# Autodesk Inventor assembly: Baugruppe1
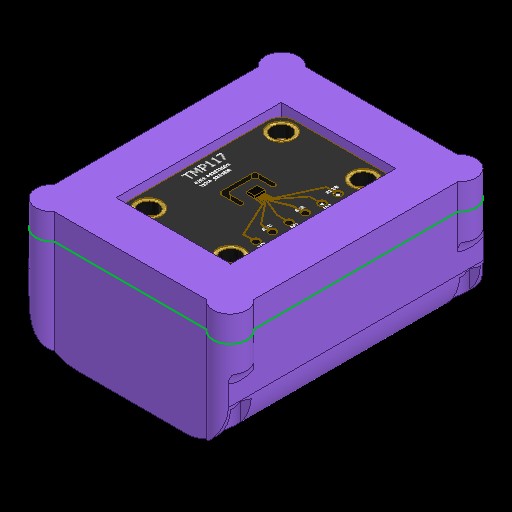
[picture p0: Inventor's stored thumbnail of the model, 512x512]
Saved by Autodesk Inventor 2027.1 (Build 311270010, 270A)
## iProperties
Created: 2026-10-09
Part Number: Baugruppe1
Document SubType Name: Assembly
Designer: josia
Author: josia
## Documents named in this file (10)
- C:\Users\josia\OneDrive\Desktop\Projekte\TemperaturSensor\tmp117_Temp_Sensor\Temp_Sensor.iam
- C:\Users\josia\OneDrive\Desktop\Projekte\TemperaturSensor\tmp117_Temp_Sensor\Verschiedene_ESP32_C3_Super_Mini_3DModele\ESP32 C3 Super mini (PINK)\ESP32 C3 Super mini (PINK).ipt
- C:\Users\josia\OneDrive\Desktop\Projekte\TemperaturSensor\tmp117_Temp_Sensor\Temp_Basis_Platte.ipt
- C:\Users\josia\OneDrive\Desktop\Projekte\TemperaturSensor\tmp117_Temp_Sensor\Pin_7mm.ipt
- C:\Users\josia\OneDrive\Desktop\Projekte\TemperaturSensor\tmp117_Temp_Sensor\charging-module-tp4057-mini-1\Charging Module TP4057 Mini\Charging Module TP4057 Mini.iam
- C:\Users\josia\OneDrive\Desktop\Projekte\TemperaturSensor\tmp117_Temp_Sensor\Li-Ion_akku_502030.ipt
- C:\Users\josia\OneDrive\Desktop\Projekte\TemperaturSensor\tmp117_Temp_Sensor\Wasserdichter_USBC_Anschluss\SS-52400-012\SS-52400-012.iam
- C:\Users\josia\OneDrive\Desktop\Projekte\TemperaturSensor\tmp117_Temp_Sensor\Basisplatte_Gehäuse.ipt
- C:\Users\josia\OneDrive\Desktop\Projekte\TemperaturSensor\tmp117_Temp_Sensor\Einschmelzgewinde_M2.ipt
- C:\Users\josia\OneDrive\Desktop\Projekte\TemperaturSensor\tmp117_Temp_Sensor\Glocke_Gehäuse.ipt
## Components (13 placed, 9 different names)
1. ESP32 C3 Super mini (PINK):1 — Passend:1, Passend:6, Fluchtend:4, Fluchtend:5, Passend:9, Passend:10, Fluchtend:6, Fluchtend:7, Fluchtend:8
2. Temp_Basis_Platte:1 — Passend:1, Passend:11, Passend:12, Passend:13, Fluchtend:11, Passend:17, Passend:18
3. Pin_7mm:1 — Passend:9, Fluchtend:6, Passend:12
4. Pin_7mm:2 — Passend:10, Fluchtend:7, Passend:11
5. Charging Module TP4057 Mini:1 [sub-assembly] — Passend:13, Passend:14, Passend:15, Fluchtend:8
6. Li-Ion_akku_502030:1 — Passend:6, Fluchtend:4, Fluchtend:5, Passend:14, Passend:15, Passend:16, Fluchtend:9, Fluchtend:10
7. SS-52400-012:1 [sub-assembly] — Passend:16, Fluchtend:9, Fluchtend:10
8. Basisplatte_Gehäuse:1 — Fluchtend:11, Passend:17, Passend:18, Passend:19, Passend:20, Passend:21, Passend:22, Passend:23, Passend:24, Passend:25, Passend:26, Passend:27
9. Einschmelzgewinde_M2:1 — Passend:19, Passend:25
10. Einschmelzgewinde_M2:2 — Passend:20, Passend:24
11. Einschmelzgewinde_M2:3 — Passend:22, Passend:23, Passend:29
12. Einschmelzgewinde_M2:4 — Passend:21, Passend:26, Passend:28
13. Glocke_Gehäuse:1 — Passend:27, Passend:28, Passend:29
## Relationships (31: Mate 23, Flush 8)
- Passend:1 [Mate] (3.5 mm): ESP32 C3 Super mini (PINK):1 ↔ Temp_Basis_Platte:1
- Passend:6 [Mate] (2.5 mm): ESP32 C3 Super mini (PINK):1 ↔ Li-Ion_akku_502030:1
- Fluchtend:4 [Flush] (1 mm): ESP32 C3 Super mini (PINK):1 ↔ Li-Ion_akku_502030:1
- Fluchtend:5 [Flush] (-1 mm): ESP32 C3 Super mini (PINK):1 ↔ Li-Ion_akku_502030:1
- Passend:9 [Mate]: ESP32 C3 Super mini (PINK):1 ↔ Pin_7mm:1
- Passend:10 [Mate]: ESP32 C3 Super mini (PINK):1 ↔ Pin_7mm:2
- Fluchtend:6 [Flush] (-0.7 mm): ESP32 C3 Super mini (PINK):1 ↔ Pin_7mm:1
- Fluchtend:7 [Flush] (-0.7 mm): ESP32 C3 Super mini (PINK):1 ↔ Pin_7mm:2
- Passend:11 [Mate]: Temp_Basis_Platte:1 ↔ Pin_7mm:2
- Passend:12 [Mate]: Temp_Basis_Platte:1 ↔ Pin_7mm:1
- Passend:13 [Mate]: Temp_Basis_Platte:1 ↔ Charging Module TP4057 Mini:1
- Passend:14 [Mate]: Charging Module TP4057 Mini:1 ↔ Li-Ion_akku_502030:1
- Passend:15 [Mate]: Charging Module TP4057 Mini:1 ↔ Li-Ion_akku_502030:1
- Fluchtend:8 [Flush]: ESP32 C3 Super mini (PINK):1 ↔ Charging Module TP4057 Mini:1
- Passend:16 [Mate]: Li-Ion_akku_502030:1 ↔ SS-52400-012:1
- Fluchtend:9 [Flush] (1.5 mm): Li-Ion_akku_502030:1 ↔ SS-52400-012:1
- Fluchtend:10 [Flush] (-2 mm): Li-Ion_akku_502030:1 ↔ SS-52400-012:1
- Fluchtend:11 [Flush] (-1 mm): Temp_Basis_Platte:1 ↔ Basisplatte_Gehäuse:1
- Passend:17 [Mate]: Temp_Basis_Platte:1 ↔ Basisplatte_Gehäuse:1
- Passend:18 [Mate]: Temp_Basis_Platte:1 ↔ Basisplatte_Gehäuse:1
- Passend:19 [Mate]: Basisplatte_Gehäuse:1 ↔ Einschmelzgewinde_M2:1
- Passend:20 [Mate]: Basisplatte_Gehäuse:1 ↔ Einschmelzgewinde_M2:2
- Passend:21 [Mate]: Basisplatte_Gehäuse:1 ↔ Einschmelzgewinde_M2:4
- Passend:22 [Mate]: Basisplatte_Gehäuse:1 ↔ Einschmelzgewinde_M2:3
- Passend:23 [Mate]: Basisplatte_Gehäuse:1 ↔ Einschmelzgewinde_M2:3
- Passend:24 [Mate]: Basisplatte_Gehäuse:1 ↔ Einschmelzgewinde_M2:2
- Passend:25 [Mate]: Basisplatte_Gehäuse:1 ↔ Einschmelzgewinde_M2:1
- Passend:26 [Mate]: Basisplatte_Gehäuse:1 ↔ Einschmelzgewinde_M2:4
- Passend:27 [Mate]: Basisplatte_Gehäuse:1 ↔ Glocke_Gehäuse:1
- Passend:28 [Mate]: Einschmelzgewinde_M2:4 ↔ Glocke_Gehäuse:1
- Passend:29 [Mate]: Einschmelzgewinde_M2:3 ↔ Glocke_Gehäuse:1
